# Autodesk Inventor assembly: 1.3_CobotArm
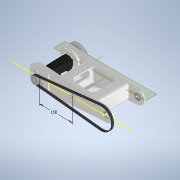
[picture p0: Inventor's stored thumbnail of the model, 180x180]
Saved by Autodesk Inventor 2021 (Build 250183000, 183)
## iProperties
Created: 2025-11-12
Part Number: 1.3_CobotArm
Document SubType Name: Assembly
Designer: Admin
Mass: 2127.25 g
Surface Area: 2706.84 cm^2
Volume: 1247.83 cm^3
Density: 1.70475 g/cm^3
Author: Admin
## Documents named in this file (14)
- C:\Users\Admin\OneDrive - Politecnico di Milano\File di Erwin Rafael Novicio - Industrial Robotics SY 25-26\3D Model\COBOT - no shaftkeys\1.3_CobotArm.iam
- C:\Users\Admin\OneDrive - Politecnico di Milano\File di Erwin Rafael Novicio - Industrial Robotics SY 25-26\3D Model\COBOT - no shaftkeys\1.3_1_SideArm.ipt
- C:\Users\Admin\OneDrive - Politecnico di Milano\File di Erwin Rafael Novicio - Industrial Robotics SY 25-26\3D Model\COBOT - no shaftkeys\HG-MR13B-D.ipt
- C:\Users\Admin\OneDrive - Politecnico di Milano\File di Erwin Rafael Novicio - Industrial Robotics SY 25-26\3D Model\COBOT - no shaftkeys\1.3_2_SideArmClose.ipt
- C:\Users\Admin\OneDrive - Politecnico di Milano\File di Erwin Rafael Novicio - Industrial Robotics SY 25-26\3D Model\COBOT - no shaftkeys\BEARING_61903-2RZ.ipt
- C:\Users\Admin\Documents\Inventor\Content Center Files\R2021\en-US\ISO 4762(2)\ISO 4762 - M4 x 20ISO.ipt
- C:\Users\Admin\Documents\Inventor\Content Center Files\R2021\en-US\ISO 4035(2)\ISO 4035 - M4 - ISO.ipt
- C:\Users\Admin\OneDrive - Politecnico di Milano\File di Erwin Rafael Novicio - Industrial Robotics SY 25-26\3D Model\COBOT - no shaftkeys\Timing_Pulley_22002-051060_V2.ipt
- C:\Users\Admin\Documents\Inventor\Content Center Files\R2021\en-US\DIN 471(1)\DIN 471 - 30x1.5.ipt
- C:\Users\Admin\OneDrive - Politecnico di Milano\File di Erwin Rafael Novicio - Industrial Robotics SY 25-26\3D Model\COBOT - no shaftkeys\Timing_Pulley_22002-051020_V2.ipt
- C:\Users\Admin\OneDrive - Politecnico di Milano\File di Erwin Rafael Novicio - Industrial Robotics SY 25-26\3D Model\COBOT - no shaftkeys\M6 Unheaded Heat-Sert Insert for Plastic.ipt
- C:\Users\Admin\Documents\Inventor\Content Center Files\R2021\en-US\ISO 4762(2)\ISO 4762 - M6 x 16ISO.ipt
- C:\Users\Admin\Documents\Inventor\Content Center Files\R2021\en-US\DIN 438\DIN 438 - M3x10.ipt
- C:\Users\Admin\OneDrive - Politecnico di Milano\File di Erwin Rafael Novicio - Industrial Robotics SY 25-26\3D Model\COBOT - no shaftkeys\TiminigBelt_B.ipt
## Components (24 placed, 13 different names)
1. 1.3_1_SideArm:1 — Mate:1, Flush:1, Mate:2, Mate:3, Mate:4, Mate:5, Mate:6, Mate:7, Mate:14, Mate:15, Mate:18, Mate:20, Flush:4, Flush:5, Mate:44, Mate:45, Mate:46, Mate:47, Flush:6, Flush:7, Flush:8, Mate:51, Mate:58
2. HG-KR13B:1 — Mate:3, Mate:4, Mate:5, Mate:19, Mate:21, Mate:43, Mate:56
3. 1.3_2_SideArmClose:1 — Flush:2, Mate:6, Mate:7, Mate:13, Mate:16, Mate:36, Flush:3, Mate:41, Mate:42, Mate:48, Mate:49, Mate:50, Mate:52, Mate:53, Mate:54, Mate:55
4. BEARING_61903-2RZ:1 — Mate:14, Mate:15
5. BEARING_61903-2RZ:2 — Mate:13, Mate:16
6. ISO 4762 M4 x 20:1 — Mate:18, Mate:19, Mate:22, Mate:24
7. ISO 4762 M4 x 20:2 — Mate:20, Mate:21, Mate:25, Mate:26
8. ISO 4035 M4:1 — Mate:22, Mate:23
9. ISO 4035 M4:2 — Mate:25, Mate:27
10. ISO 4035 M4:3 — Mate:23, Mate:24
11. ISO 4035 M4:4 — Mate:26, Mate:27
12. Timing_Pulley_22002-051060_V2:1 — Mate:36, Flush:3
13. DIN 471 30x1.5:1 — Mate:41, Mate:42
14. Timing_Pulley_22002-051020_V2:1 — Flush:4, Mate:43, Mate:56, Mate:57, Mate:59, Flush:9
15. M6 Unheaded Heat-Sert Insert for Plastic:1 — Flush:5, Mate:44
16. M6 Unheaded Heat-Sert Insert for Plastic:2 — Mate:47, Flush:6
17. M6 Unheaded Heat-Sert Insert for Plastic:3 — Mate:45, Flush:7
18. M6 Unheaded Heat-Sert Insert for Plastic:4 — Mate:46, Flush:8
19. ISO 4762 M6 x 16:1 — Mate:48, Mate:49
20. ISO 4762 M6 x 16:2 — Mate:50, Mate:53
21. ISO 4762 M6 x 16:3 — Mate:52, Mate:54
22. ISO 4762 M6 x 16:4 — Mate:51, Mate:55
23. DIN 438 M3x10:1 — Mate:57
24. TiminigBelt_B:1 — Mate:58, Mate:59, Flush:9
## Relationships (50: Mate 41, Flush 9)
- Mate:1 (-67 mm): 1.3_1_SideArm:1
- Flush:1: 1.3_1_SideArm:1
- Mate:2: 1.3_1_SideArm:1
- Mate:3: 1.3_1_SideArm:1 ↔ HG-KR13B:1
- Mate:4: 1.3_1_SideArm:1 ↔ HG-KR13B:1
- Mate:5: 1.3_1_SideArm:1 ↔ HG-KR13B:1
- Flush:2 (-67 mm): 1.3_2_SideArmClose:1
- Mate:6: 1.3_1_SideArm:1 ↔ 1.3_2_SideArmClose:1
- Mate:7: 1.3_1_SideArm:1 ↔ 1.3_2_SideArmClose:1
- Mate:13: 1.3_2_SideArmClose:1 ↔ BEARING_61903-2RZ:2
- Mate:14: 1.3_1_SideArm:1 ↔ BEARING_61903-2RZ:1
- Mate:15: 1.3_1_SideArm:1 ↔ BEARING_61903-2RZ:1
- Mate:16: 1.3_2_SideArmClose:1 ↔ BEARING_61903-2RZ:2
- Mate:18: 1.3_1_SideArm:1 ↔ ISO 4762 M4 x 20:1
- Mate:19: HG-KR13B:1 ↔ ISO 4762 M4 x 20:1
- Mate:20: 1.3_1_SideArm:1 ↔ ISO 4762 M4 x 20:2
- Mate:21: HG-KR13B:1 ↔ ISO 4762 M4 x 20:2
- Mate:22: ISO 4762 M4 x 20:1 ↔ ISO 4035 M4:1
- Mate:23: ISO 4035 M4:1 ↔ ISO 4035 M4:3
- Mate:24: ISO 4762 M4 x 20:1 ↔ ISO 4035 M4:3
- Mate:25: ISO 4762 M4 x 20:2 ↔ ISO 4035 M4:2
- Mate:26: ISO 4762 M4 x 20:2 ↔ ISO 4035 M4:4
- Mate:27: ISO 4035 M4:2 ↔ ISO 4035 M4:4
- Mate:36: 1.3_2_SideArmClose:1 ↔ Timing_Pulley_22002-051060_V2:1
- Flush:3: 1.3_2_SideArmClose:1 ↔ Timing_Pulley_22002-051060_V2:1
- Mate:41: 1.3_2_SideArmClose:1 ↔ DIN 471 30x1.5:1
- Mate:42: 1.3_2_SideArmClose:1 ↔ DIN 471 30x1.5:1
- Flush:4 (24 mm): 1.3_1_SideArm:1 ↔ Timing_Pulley_22002-051020_V2:1
- Mate:43: HG-KR13B:1 ↔ Timing_Pulley_22002-051020_V2:1
- Flush:5: 1.3_1_SideArm:1 ↔ M6 Unheaded Heat-Sert Insert for Plastic:1
- Mate:44: 1.3_1_SideArm:1 ↔ M6 Unheaded Heat-Sert Insert for Plastic:1
- Mate:45: 1.3_1_SideArm:1 ↔ M6 Unheaded Heat-Sert Insert for Plastic:3
- Mate:46: 1.3_1_SideArm:1 ↔ M6 Unheaded Heat-Sert Insert for Plastic:4
- Mate:47: 1.3_1_SideArm:1 ↔ M6 Unheaded Heat-Sert Insert for Plastic:2
- Flush:6: 1.3_1_SideArm:1 ↔ M6 Unheaded Heat-Sert Insert for Plastic:2
- Flush:7: 1.3_1_SideArm:1 ↔ M6 Unheaded Heat-Sert Insert for Plastic:3
- Flush:8: 1.3_1_SideArm:1 ↔ M6 Unheaded Heat-Sert Insert for Plastic:4
- Mate:48: 1.3_2_SideArmClose:1 ↔ ISO 4762 M6 x 16:1
- Mate:49: 1.3_2_SideArmClose:1 ↔ ISO 4762 M6 x 16:1
- Mate:50: 1.3_2_SideArmClose:1 ↔ ISO 4762 M6 x 16:2
- Mate:51: 1.3_1_SideArm:1 ↔ ISO 4762 M6 x 16:4
- Mate:52: 1.3_2_SideArmClose:1 ↔ ISO 4762 M6 x 16:3
- Mate:53: 1.3_2_SideArmClose:1 ↔ ISO 4762 M6 x 16:2
- Mate:54: 1.3_2_SideArmClose:1 ↔ ISO 4762 M6 x 16:3
- Mate:55: 1.3_2_SideArmClose:1 ↔ ISO 4762 M6 x 16:4
- Mate:56: HG-KR13B:1 ↔ Timing_Pulley_22002-051020_V2:1
- Mate:57: Timing_Pulley_22002-051020_V2:1 ↔ DIN 438 M3x10:1
- Mate:58: 1.3_1_SideArm:1 ↔ TiminigBelt_B:1
- Mate:59: Timing_Pulley_22002-051020_V2:1 ↔ TiminigBelt_B:1
- Flush:9 (-2.5 mm): Timing_Pulley_22002-051020_V2:1 ↔ TiminigBelt_B:1
